# Autodesk Inventor assembly: MM0948AN130_G11_001
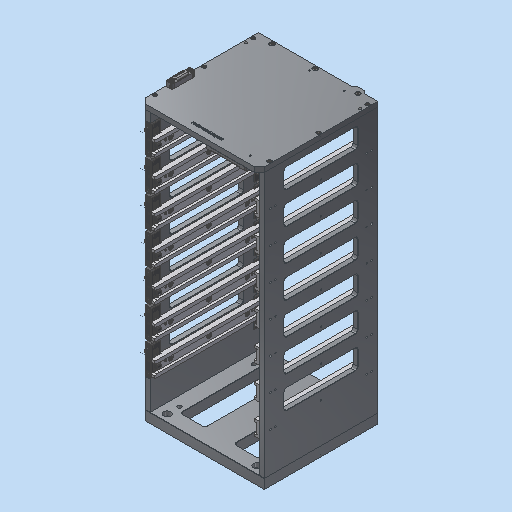
[picture p0: Inventor's stored thumbnail of the model, 512x512]
Saved by Autodesk Inventor 2023.3 (Build 273359000, 359)
## iProperties
Part Number: MM0948AN130_G11_001
Material: Generisch
Description: =<RBPARTNOTITLE2>
Document SubType Name: Assembly
Designer: FH/Wi
Mass: 10189.8 g
Surface Area: 11065.3 cm^2
Volume: 3738.18 cm^3
Density: 2.72587 g/cm^3
Created: 2023-03-23
RBCHANGEDESCRIPTION1: Erstfreigabe
RBCHANGENO1: 00
RBDOCUMENTTYPE: DRF
RBDOCUMENTVERSION: 00
RBDRAWINGMAINSCALE: 1:1
RBDRAWINGMISSINGSPEC: --
RBDRAWINGVOLUME: --
RBDSV1: 0850
RBGBDETAILS: 43274
RBGBEDGESIN1: +0,5
RBGBEDGESIN2: +0,2
RBGBEDGESOUT1: -0,3
RBGBEDGESOUT2: -0,1
RBMATERIAL: =<Material>
RBMATMEETS: --
RBMATNO: =<Part Number>
RBORGUNITRESPONSIBLE1: AnP/TEF1
RBPARTMADEOF: --
RBPARTNO: SIEHE MNR
RBPARTNOTITLE1: CIPG mask depot
RBPARTNOTITLE2: CIPG Maskenmagazin
RBPARTSAFETYINDICATOR: --
RBSURFACE: --
RBSURFACE2: --
RBZEDGESNORM: ISO13715:2002-06
RBZGENDIMCLASS: m
RBZGENDIMNORM: ISO 2768-1:1989-11
RBZGENGEOCLASS: H
RBZGENGEONORM: ISO 2768-2:1989-11
RBZSURFACENORM: ISO13D2:2002-02
RBZTOLERANCENORM: ISO 14405-1:2010-12
AnP_Kommentar: --
MaxAbmaße: --
AnP_TemplVers: 20190222
AnP_Kategorie: 99
AnP_Material: =<Material>
Author: FH/Wi
Keywords: =<RBPARTMADEOF>
Comments: =<RBSURFACE2>
Revision Number: 01
## Documents named in this file (21)
- C:\Users\rea9an\Documents\Inventor\TCAI2412_te1910_EM\AS00000948.iam
- C:\Users\rea9an\Documents\Inventor\TCAI2412_te1910_EM\PT00004919.ipt
- C:\Users\rea9an\Documents\Inventor\TCAI2412_te1910_EM\PT00004872.ipt
- C:\Users\rea9an\Documents\Inventor\TCAI2412_te1910_EM\PT00004867.ipt
- C:\Users\rea9an\Documents\Inventor\TCAI2412_te1910_EM\PT00004831.ipt
- C:\Users\rea9an\Documents\Inventor\TCAI2412_te1910_EM\PT00004913.ipt
- C:\Users\rea9an\Documents\Inventor\TCAI2412_te1910_EM\PT00004918.ipt
- C:\Users\rea9an\Documents\Inventor\TCAI2412_te1910_EM\AS00000947.iam
- C:\Users\rea9an\Documents\Inventor\TCAI2412_te1910_EM\PT00004397.ipt
- C:\Users\rea9an\Documents\Inventor\TCAI2412_te1910_EM\PT00004836.ipt
- C:\Users\rea9an\Documents\Inventor\TCAI2412_te1910_EM\PT00004789.ipt
- C:\Users\rea9an\Documents\Inventor\TCAI2412_te1910_EM\PT00004842.ipt
- C:\Users\rea9an\Documents\Inventor\TCAI2412_te1910_EM\PT00004571.ipt
- C:\Users\rea9an\Documents\Inventor\TCAI2412_te1910_EM\PT00004833.ipt
- C:\Users\rea9an\Documents\Inventor\TCAI2412_te1910_EM\PT00004647.ipt
- C:\Users\rea9an\Documents\Inventor\TCAI2412_te1910_EM\PT00004648.ipt
- C:\Users\rea9an\Documents\Inventor\TCAI2412_te1910_EM\PT00004649.ipt
- C:\Users\rea9an\Documents\Inventor\TCAI2412_te1910_EM\PT00004650.ipt
- C:\Users\rea9an\Documents\Inventor\TCAI2412_te1910_EM\PT00004651.ipt
- C:\Users\rea9an\Documents\Inventor\TCAI2412_te1910_EM\PT00004652.ipt
- C:\Users\rea9an\Documents\Inventor\TCAI2412_te1910_EM\PT00004653.ipt
## Components (131 placed, 20 different names)
1. PT00004648:1 — Passend:11, Fluchtend:10, Einfügen:9, Einfügen:10, Einfügen:11, Einfügen:12, Einfügen:27, Einfügen:28, Einfügen:34, Passend:30, Einfügen:39, Einfügen:40, Einfügen:41, Passend:34, Passend:35, Fluchtend:15, Passend:39, Passend:40, Passend:41
2. PT00004651:1 — Passend:1, Passend:2, Fluchtend:1, Fluchtend:3, Fluchtend:4, Fluchtend:9, Einfügen:1, Einfügen:2, Einfügen:3, Einfügen:4, Einfügen:5, Einfügen:6, Einfügen:7, Einfügen:8, Einfügen:37, Einfügen:38
3. PT00004649:1 — Passend:1, Fluchtend:1, Passend:6, Passend:7, Passend:8, Fluchtend:9, Fluchtend:10, Passend:36
4. PT00004650:1 — Passend:2, Fluchtend:3, Fluchtend:4, Passend:3, Passend:4, Passend:5, Passend:11, Fluchtend:13, Passend:26, Passend:27, Passend:31, Passend:32, Fluchtend:14, Passend:33
5. PT00004647:1 — Passend:35, Fluchtend:15, Passend:36, Fluchtend:16, Passend:37, Passend:38
6. PT00004571:1 — Fluchtend:16, Passend:37, Passend:38
7. PT00004833:1 — Passend:41
8. PT00004833:2 — Passend:40
9. PT00004833:3 — Passend:39
10. PT00004397:1 — Einfügen:34, Passend:30, Einfügen:35, Einfügen:36
11. PT00004918:1 — Einfügen:27
12. PT00004918:2 — Einfügen:28
13. PT00004919:1 — Einfügen:4
14. PT00004919:2 — Einfügen:3
15. PT00004919:3 — Einfügen:2
16. PT00004919:4 — Einfügen:1
17. PT00004872:1 — Einfügen:8
18. PT00004872:2 — Einfügen:7
19. PT00004872:3 — Einfügen:6
20. PT00004872:4 — Einfügen:5
21. PT00004867:1 — Einfügen:12
22. PT00004867:2 — Einfügen:11
23. PT00004867:3 — Einfügen:10
24. PT00004867:4 — Einfügen:9
25. PT00004836:1 — Einfügen:35
26. PT00004836:2 — Einfügen:36
27. PT00004872:5 — Einfügen:38
28. PT00004872:6 — Einfügen:37
29. PT00004867:5 — Einfügen:40
30. PT00004867:6 — Einfügen:39, Passend:33
31. PT00004789:1 — Einfügen:41, Passend:34, Einfügen:46, Einfügen:47
32. PT00004842:3 — Einfügen:47
33. PT00004842:4 — Einfügen:46
34. PT00004652:1 — Passend:3, Passend:4, Passend:5, Passend:14, Passend:15, Passend:16, Einfügen:20, Einfügen:21
35. PT00004653:1 — Passend:6, Passend:7, Passend:8, Einfügen:22, Einfügen:23, Passend:17, Passend:18, Passend:19
36. PT00004913:3 — Einfügen:20
37. PT00004831:3 — Passend:14
38. PT00004831:2 — Passend:15
39. PT00004831:1 — Passend:16
40. PT00004913:2 — Einfügen:21
41. PT00004913:1 — Einfügen:22
42. PT00004831:6 — Passend:17
43. PT00004831:5 — Passend:18
44. PT00004831:4 — Passend:19
45. PT00004913:4 — Einfügen:23
46. AS00000947:1 [sub-assembly] — Fluchtend:13, Passend:26, Passend:27
47. AS00000947:2 [sub-assembly] — Passend:31, Passend:32, Fluchtend:14
48. PT00004652:2
49. PT00004653:2
50. PT00004913:5
51. PT00004831:7
52. PT00004831:12
53. PT00004831:17
54. PT00004913:10
55. PT00004913:15
56. PT00004831:22
57. PT00004831:27
58. PT00004831:32
59. PT00004913:20
60. AS00000947:3 [sub-assembly]
61. AS00000947:8 [sub-assembly]
62. PT00004652:3
63. PT00004653:3
64. PT00004913:6
65. PT00004831:8
66. PT00004831:13
67. PT00004831:18
68. PT00004913:11
69. PT00004913:16
70. PT00004831:23
71. PT00004831:28
72. PT00004831:33
73. PT00004913:21
74. AS00000947:4 [sub-assembly]
75. AS00000947:9 [sub-assembly]
76. PT00004652:4
77. PT00004653:4
78. PT00004913:7
79. PT00004831:9
80. PT00004831:14
81. PT00004831:19
82. PT00004913:12
83. PT00004913:17
84. PT00004831:24
85. PT00004831:29
86. PT00004831:34
87. PT00004913:22
88. AS00000947:5 [sub-assembly]
89. AS00000947:10 [sub-assembly]
90. PT00004652:5
91. PT00004653:5
92. PT00004913:8
93. PT00004831:10
94. PT00004831:15
95. PT00004831:20
96. PT00004913:13
97. PT00004913:18
98. PT00004831:25
99. PT00004831:30
100. PT00004831:35
101. PT00004913:23
102. AS00000947:6 [sub-assembly]
103. AS00000947:11 [sub-assembly]
104. PT00004652:6
105. PT00004653:6
106. PT00004913:9
107. PT00004831:11
108. PT00004831:16
109. PT00004831:21
110. PT00004913:14
111. PT00004913:19
112. PT00004831:26
113. PT00004831:31
114. PT00004831:36
115. PT00004913:24
116. AS00000947:7 [sub-assembly]
117. AS00000947:12 [sub-assembly]
118. PT00004652:7
119. PT00004653:7
120. PT00004913:25
121. PT00004831:37
122. PT00004831:38
123. PT00004831:39
124. PT00004913:26
125. PT00004913:27
126. PT00004831:40
127. PT00004831:41
128. PT00004831:42
129. PT00004913:28
130. AS00000947:13 [sub-assembly]
131. AS00000947:14 [sub-assembly]
## Component patterns: (7 elements, first: PT00004652:1 + PT00004653:1 + PT00004913:3 + PT00004831:3 + PT00004831:2 + PT00004831:1 + PT00004913:2 + PT00004913:1 + PT00004831:6 + PT00004831:5 + PT00004831:4 + PT00004913:4 + AS00000947:1 + AS00000947:2)
## Relationships (66: Mate 29, Insert 28, Flush 9)
- Passend:1 [Mate]: PT00004651:1 ↔ PT00004649:1
- Passend:2 [Mate]: PT00004651:1 ↔ PT00004650:1
- Fluchtend:1 [Flush]: PT00004651:1 ↔ PT00004649:1
- Fluchtend:3 [Flush]: PT00004651:1 ↔ PT00004650:1
- Fluchtend:4 [Flush]: PT00004651:1 ↔ PT00004650:1
- Passend:3 [Mate]: PT00004650:1 ↔ PT00004652:1
- Passend:4 [Mate]: PT00004650:1 ↔ PT00004652:1
- Passend:5 [Mate]: PT00004650:1 ↔ PT00004652:1
- Passend:6 [Mate]: PT00004649:1 ↔ PT00004653:1
- Passend:7 [Mate]: PT00004649:1 ↔ PT00004653:1
- Passend:8 [Mate]: PT00004649:1 ↔ PT00004653:1
- Fluchtend:9 [Flush]: PT00004651:1 ↔ PT00004649:1
- Passend:11 [Mate]: PT00004648:1 ↔ PT00004650:1
- Fluchtend:10 [Flush]: PT00004648:1 ↔ PT00004649:1
- Einfügen:1 [Insert] (-1 mm): PT00004651:1 ↔ PT00004919:4
- Einfügen:2 [Insert] (-1 mm): PT00004651:1 ↔ PT00004919:3
- Einfügen:3 [Insert] (-1 mm): PT00004651:1 ↔ PT00004919:2
- Einfügen:4 [Insert] (-1 mm): PT00004651:1 ↔ PT00004919:1
- Einfügen:5 [Insert]: PT00004651:1 ↔ PT00004872:4
- Einfügen:6 [Insert]: PT00004651:1 ↔ PT00004872:3
- Einfügen:7 [Insert]: PT00004651:1 ↔ PT00004872:2
- Einfügen:8 [Insert]: PT00004651:1 ↔ PT00004872:1
- Einfügen:9 [Insert]: PT00004648:1 ↔ PT00004867:4
- Einfügen:10 [Insert]: PT00004648:1 ↔ PT00004867:3
- Einfügen:11 [Insert]: PT00004648:1 ↔ PT00004867:2
- Einfügen:12 [Insert]: PT00004648:1 ↔ PT00004867:1
- Passend:14 [Mate]: PT00004652:1 ↔ PT00004831:3
- Passend:15 [Mate]: PT00004652:1 ↔ PT00004831:2
- Passend:16 [Mate]: PT00004652:1 ↔ PT00004831:1
- Einfügen:20 [Insert]: PT00004652:1 ↔ PT00004913:3
- Einfügen:21 [Insert]: PT00004652:1 ↔ PT00004913:2
- Einfügen:22 [Insert]: PT00004653:1 ↔ PT00004913:1
- Einfügen:23 [Insert]: PT00004653:1 ↔ PT00004913:4
- Passend:17 [Mate]: PT00004653:1 ↔ PT00004831:6
- Passend:18 [Mate]: PT00004653:1 ↔ PT00004831:5
- Passend:19 [Mate]: PT00004653:1 ↔ PT00004831:4
- Einfügen:27 [Insert]: PT00004648:1 ↔ PT00004918:1
- Einfügen:28 [Insert]: PT00004648:1 ↔ PT00004918:2
- Fluchtend:13 [Flush]: PT00004650:1 ↔ AS00000947:1
- Passend:26 [Mate]: PT00004650:1 ↔ AS00000947:1
- Passend:27 [Mate]: PT00004650:1 ↔ AS00000947:1
- Einfügen:34 [Insert]: PT00004648:1 ↔ PT00004397:1
- Passend:30 [Mate]: PT00004648:1 ↔ PT00004397:1
- Einfügen:35 [Insert]: PT00004397:1 ↔ PT00004836:1
- Einfügen:36 [Insert]: PT00004397:1 ↔ PT00004836:2
- Passend:31 [Mate]: PT00004650:1 ↔ AS00000947:2
- Passend:32 [Mate]: PT00004650:1 ↔ AS00000947:2
- Fluchtend:14 [Flush]: PT00004650:1 ↔ AS00000947:2
- Einfügen:37 [Insert]: PT00004651:1 ↔ PT00004872:6
- Einfügen:38 [Insert]: PT00004651:1 ↔ PT00004872:5
- Einfügen:39 [Insert]: PT00004648:1 ↔ PT00004867:6
- Einfügen:40 [Insert]: PT00004648:1 ↔ PT00004867:5
- Passend:33 [Mate]: PT00004650:1 ↔ PT00004867:6
- Einfügen:41 [Insert]: PT00004648:1 ↔ PT00004789:1
- Passend:34 [Mate]: PT00004648:1 ↔ PT00004789:1
- Einfügen:46 [Insert]: PT00004789:1 ↔ PT00004842:4
- Einfügen:47 [Insert]: PT00004789:1 ↔ PT00004842:3
- Passend:35 [Mate]: PT00004648:1 ↔ PT00004647:1
- Fluchtend:15 [Flush]: PT00004648:1 ↔ PT00004647:1
- Passend:36 [Mate] (1.5 mm): PT00004649:1 ↔ PT00004647:1
- Fluchtend:16 [Flush]: PT00004647:1 ↔ PT00004571:1
- Passend:37 [Mate] (1.5 mm): PT00004647:1 ↔ PT00004571:1
- Passend:38 [Mate]: PT00004647:1 ↔ PT00004571:1
- Passend:39 [Mate]: PT00004648:1 ↔ PT00004833:3
- Passend:40 [Mate]: PT00004648:1 ↔ PT00004833:2
- Passend:41 [Mate]: PT00004648:1 ↔ PT00004833:1
